# Autodesk Inventor assembly: esp32-based-iot-switch
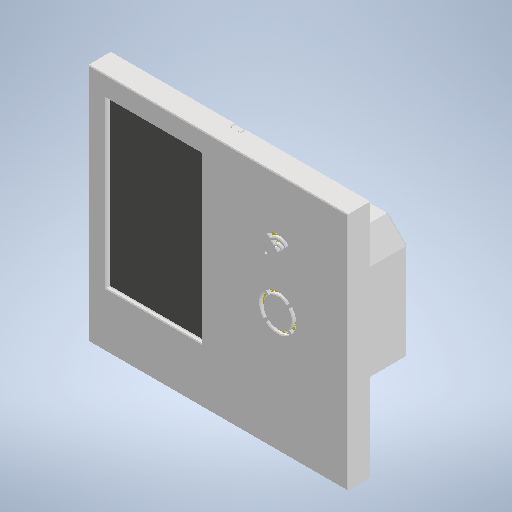
[picture p0: Inventor's stored thumbnail of the model, 512x512]
Saved by Autodesk Inventor 2025.2 (Build 292293000, 293)
## iProperties
Created: 2026-06-16
Part Number: esp32-based-iot-switch
Document SubType Name: Assembly
Designer: Bruno
Author: Bruno
## Documents named in this file (12)
- D:\GITHUB\esp32-based-iot-switch\CAD\esp32-based-iot-switch.iam
- D:\GITHUB\esp32-based-iot-switch\CAD\Socket.ipt
- D:\GITHUB\esp32-based-iot-switch\CAD\M3-5_7mm-heat-insert.ipt
- D:\GITHUB\esp32-based-iot-switch\CAD\PCB-A\PCB-A.iam
- D:\GITHUB\esp32-based-iot-switch\CAD\Separator.ipt
- D:\GITHUB\esp32-based-iot-switch\CAD\Back.ipt
- D:\GITHUB\esp32-based-iot-switch\CAD\PCB-B\PCB-B.iam
- D:\GITHUB\esp32-based-iot-switch\CAD\GDEY037T03.ipt
- D:\GITHUB\esp32-based-iot-switch\CAD\Front.ipt
- D:\GITHUB\esp32-based-iot-switch\CAD\M3-10mm-SHS.ipt
- D:\GITHUB\esp32-based-iot-switch\CAD\Screen_holder.ipt
- D:\GITHUB\esp32-based-iot-switch\CAD\6-32screw.ipt
## Components (16 placed, 11 different names)
1. Socket:1 — Mate:20, Mate:21, Mate:4, Mate:5, Mate:6, Mate:7, Mate:8, Mate:9, Flush:1, Flush:2, Flush:3, Mate:15, Flush:8
2. M3-5_7mm-heat-insert:1 — Mate:4, Flush:1, Angle:3
3. M3-5_7mm-heat-insert:2 — Mate:5, Flush:2, Angle:4
4. M3-5_7mm-heat-insert:3 — Mate:6, Flush:3, Angle:5
5. PCB-A:1 [sub-assembly] — Mate:7, Mate:8, Mate:9, Mate:10, Mate:11, Mate:12
6. Separator:1 — Mate:10, Mate:11, Mate:12, Mate:13, Mate:14
7. Back:1 — Mate:13, Mate:14, Mate:15, Mate:16, Mate:17, Mate:18, Flush:7, Mate:22, Mate:23, Mate:24, Mate:25, Mate:26, Mate:27, Mate:28, Mate:29, Mate:30, Flush:9, Mate:31, Mate:35, Mate:36, Flush:10, Mate:37, Mate:38, Mate:39
8. PCB-B:1 [sub-assembly] — Mate:16, Mate:17, Mate:18
9. GDEY037T03:1 — Angle:2, Mate:32, Mate:33, Mate:34
10. Front:1 — Flush:7, Mate:22, Mate:23
11. M3-10mm-SHS:1 — Mate:24, Angle:6, Mate:28
12. M3-10mm-SHS:2 — Mate:25, Angle:7, Mate:27
13. M3-10mm-SHS:3 — Mate:26, Angle:8, Mate:29
14. Screen_holder:1 — Mate:30, Flush:9, Mate:31, Mate:32, Mate:33, Mate:34
15. 6-32screw:1 — Mate:35, Mate:36, Mate:39
16. 6-32screw:2 — Flush:10, Mate:37, Mate:38
## Relationships (49: Mate 35, Flush 7, Angle 7)
- Mate:20 (2.325 mm): Socket:1
- Mate:21: Socket:1
- Mate:4: Socket:1 ↔ M3-5_7mm-heat-insert:1
- Mate:5: Socket:1 ↔ M3-5_7mm-heat-insert:2
- Mate:6: Socket:1 ↔ M3-5_7mm-heat-insert:3
- Mate:7: Socket:1 ↔ PCB-A:1
- Mate:8: Socket:1 ↔ PCB-A:1
- Mate:9: Socket:1 ↔ PCB-A:1
- Flush:1: Socket:1 ↔ M3-5_7mm-heat-insert:1
- Flush:2: Socket:1 ↔ M3-5_7mm-heat-insert:2
- Flush:3: Socket:1 ↔ M3-5_7mm-heat-insert:3
- Mate:10: PCB-A:1 ↔ Separator:1
- Mate:11: PCB-A:1 ↔ Separator:1
- Mate:12: PCB-A:1 ↔ Separator:1
- Mate:13: Separator:1 ↔ Back:1
- Mate:14: Separator:1 ↔ Back:1
- Mate:15: Socket:1 ↔ Back:1
- Mate:16: Back:1 ↔ PCB-B:1
- Mate:17: Back:1 ↔ PCB-B:1
- Mate:18: Back:1 ↔ PCB-B:1
- Angle:2 (0 deg): GDEY037T03:1
- Angle:3 (0 deg): M3-5_7mm-heat-insert:1
- Angle:4 (0 deg): M3-5_7mm-heat-insert:2
- Angle:5 (0 deg): M3-5_7mm-heat-insert:3
- Flush:7: Back:1 ↔ Front:1
- Mate:22 (0.1 mm): Back:1 ↔ Front:1
- Mate:23 (0.1 mm): Back:1 ↔ Front:1
- Mate:24: Back:1 ↔ M3-10mm-SHS:1
- Mate:25: Back:1 ↔ M3-10mm-SHS:2
- Mate:26: Back:1 ↔ M3-10mm-SHS:3
- Angle:6 (0 deg): M3-10mm-SHS:1
- Angle:7 (0 deg): M3-10mm-SHS:2
- Angle:8 (0 deg): M3-10mm-SHS:3
- Mate:27: Back:1 ↔ M3-10mm-SHS:2
- Mate:28: Back:1 ↔ M3-10mm-SHS:1
- Mate:29: Back:1 ↔ M3-10mm-SHS:3
- Flush:8: Socket:1
- Mate:30: Back:1 ↔ Screen_holder:1
- Flush:9 (-1.7 mm): Back:1 ↔ Screen_holder:1
- Mate:31 (0.1 mm): Back:1 ↔ Screen_holder:1
- Mate:32 (0.1 mm): GDEY037T03:1 ↔ Screen_holder:1
- Mate:33: GDEY037T03:1 ↔ Screen_holder:1
- Mate:34: GDEY037T03:1 ↔ Screen_holder:1
- Mate:35 (1.75 mm): Back:1 ↔ 6-32screw:1
- Mate:36 (1.75 mm): Back:1 ↔ 6-32screw:1
- Flush:10 (-1.75 mm): Back:1 ↔ 6-32screw:2
- Mate:37 (1.75 mm): Back:1 ↔ 6-32screw:2
- Mate:38: Back:1 ↔ 6-32screw:2
- Mate:39: Back:1 ↔ 6-32screw:1
